# Autodesk Inventor assembly: MM0943AN106_G10_001
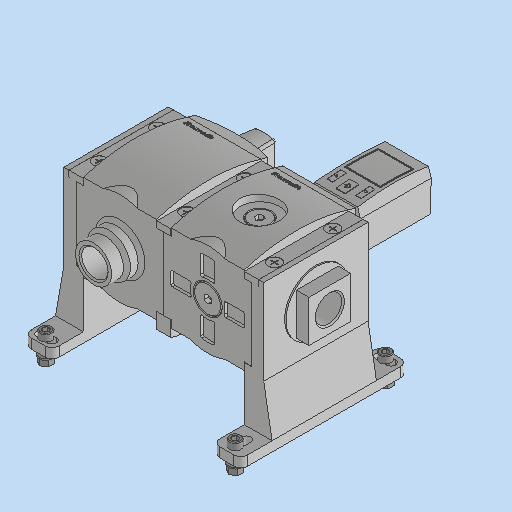
[picture p0: Inventor's stored thumbnail of the model, 512x512]
Saved by Autodesk Inventor 2023.3 (Build 273359000, 359)
## iProperties
Created: 2024-12-03
Part Number: MM0943AN106_G10_001
Description: =<RBPARTNOTITLE2>
Document SubType Name: Assembly
Designer: RIC7AN
Mass: 875.604 g
Surface Area: 1348.63 cm^2
Volume: 853.727 cm^3
Density: 1.02563 g/cm^3
RBPARTMADEOF: --
RBDRAWINGMISSINGSPEC: --
AnP_Kategorie: 99
RBPARTNOTITLE2: Pneumatikeinheit
RBSURFACE: --
RBPARTNOTITLE1: pneumatic unit
AnP_Material: =<Material>
RBMATERIAL: =<Material>
RBMATNO: =<Part Number>
RBPARTNO: SIEHE MNR
Author: RIC7AN
Keywords: =<RBPARTMADEOF>
Comments: =<RBSURFACE2>
Revision Number: 01
## Documents named in this file (10)
- C:\Users\rea9an\Documents\Inventor\TCAI2412_te1910_EM\AS00000924.iam
- C:\Users\rea9an\Documents\Inventor\TCAI2412_te1910_EM\PT00004487.ipt
- C:\Users\rea9an\Documents\Inventor\TCAI2412_te1910_EM\PT00004486.ipt
- C:\Users\rea9an\Documents\Inventor\TCAI2412_te1910_EM\PT00004489.ipt
- C:\Users\rea9an\Documents\Inventor\TCAI2412_te1910_EM\PT00004490.ipt
- C:\Users\rea9an\Documents\Inventor\TCAI2412_te1910_EM\PT00004491.ipt
- C:\Users\rea9an\Documents\Inventor\TCAI2412_te1910_EM\PT00004488.ipt
- C:\Users\rea9an\Documents\Inventor\TCAI2412_te1910_EM\PT00004819.ipt
- C:\Users\rea9an\Documents\Inventor\TCAI2412_te1910_EM\PT00004779.ipt
- C:\Users\rea9an\Documents\Inventor\TCAI2412_te1910_EM\PT00004878.ipt
## Components (19 placed, 9 different names)
1. PT00004487:1
2. PT00004486:1
3. PT00004489:1
4. PT00004489:2
5. PT00004490:1
6. PT00004491:1
7. PT00004488:1
8. PT00004878:1 — Einfügen:8
9. PT00004878:2 — Einfügen:9
10. PT00004878:3
11. PT00004878:4 — Einfügen:10
12. PT00004819:1 — Einfügen:3
13. PT00004779:1 — Einfügen:3
14. PT00004819:2 — Einfügen:8
15. PT00004779:2
16. PT00004819:3 — Einfügen:9
17. PT00004779:3
18. PT00004819:4 — Einfügen:10
19. PT00004779:4
## Relationships (23: Insert 10, Flush 7, Mate 5, Angle 1)
- [Flush]: PT00004487:1 ↔ PT00004486:1
- [Flush]: PT00004487:1 ↔ PT00004486:1
- [Flush] (-63 mm): PT00004487:1 ↔ PT00004486:1
- [Flush]: PT00004486:1 ↔ PT00004489:1
- [Flush]: PT00004486:1 ↔ PT00004489:1
- [Mate]: PT00004486:1 ↔ PT00004489:1
- [Flush]: PT00004489:1 ↔ PT00004489:2
- [Mate]: PT00004489:1 ↔ PT00004489:2
- [Mate]: PT00004487:1 ↔ PT00004489:2
- [Mate] (0.25 mm): PT00004486:1 ↔ PT00004490:1
- [Mate]: PT00004486:1 ↔ PT00004490:1
- [Flush]: PT00004486:1 ↔ PT00004490:1
- [Insert]: PT00004491:1 ↔ PT00004488:1
- [Insert]: PT00004487:1 ↔ PT00004491:1
- [Angle] (180 deg): PT00004489:1 ↔ PT00004488:1
- Einfügen:3 [Insert]: PT00004819:1 ↔ PT00004779:1
- [Insert]: PT00004878:3 ↔ PT00004819:1
- [Insert]: PT00004819:2 ↔ PT00004779:2
- [Insert]: PT00004819:3 ↔ PT00004779:3
- [Insert]: PT00004819:4 ↔ PT00004779:4
- Einfügen:8 [Insert]: PT00004878:1 ↔ PT00004819:2
- Einfügen:9 [Insert]: PT00004878:2 ↔ PT00004819:3
- Einfügen:10 [Insert]: PT00004878:4 ↔ PT00004819:4
## Named parameters: d28_d26 = 0 mm, d29_d26 = 0 mm, d30_d26 = 0 mm
